# Autodesk Inventor assembly: Z-Axis
(part 2 of 2)
- Mate:131: Suction Cup Fixation:1 ↔ ISO 4762 M4 x 16:7
- Mate:132: Suction Cup Fixation:1 ↔ ISO 4762 M4 x 16:7
- Mate:133: Suction Cup Fixation:1 ↔ ISO 4762 M4 x 16:6
- Mate:134: SK12 SHAFT HOLDER:1 ↔ ISO 4762 M5 x 20:14
- Mate:135: SK12 SHAFT HOLDER:1 ↔ ISO 4762 M5 x 20:14
- Mate:136: SK12 SHAFT HOLDER:1 ↔ ISO 4762 M5 x 20:13
- Mate:137: SK12 SHAFT HOLDER:1 ↔ ISO 4762 M5 x 20:13
- Mate:144: Suction:1 ↔ Product Base:1
- Mate:145: Suction:1 ↔ Product Base:1
- Mate:146: SK12 SHAFT HOLDER:1 ↔ IPCF06-02:1
- Mate:147: Suction:1 ↔ IPCF06-02:1
- Mate:148: Linear Bearing Spacer:1 ↔ ISO 4762 M4 x 12:4
- Mate:149: Linear Bearing Spacer:1 ↔ ISO 4762 M4 x 12:3
- Mate:150: Suction Cup Fixation:1 ↔ ISO 4762 M4 x 12:6
- Mate:151: Suction Cup Fixation:1 ↔ ISO 4762 M4 x 12:5
- Mate:152: Suction Cup Fixation:1 ↔ ISO 4762 M4 x 12:7
- Mate:153: Suction Cup Fixation:1 ↔ ISO 4762 M4 x 12:8
- Mate:154: Suction Cup Fixation:1 ↔ ISO 4762 M4 x 12:6
- Mate:155: Suction Cup Fixation:1 ↔ ISO 4762 M4 x 12:5
- Mate:156: Suction Cup Fixation:1 ↔ ISO 4762 M4 x 12:8
- Mate:157: Suction Cup Fixation:1 ↔ ISO 4762 M4 x 12:7
- Mate:158: ISO 4762 M5 x 20:14 ↔ ISO 4032 M5:13
- Mate:160: ISO 4762 M5 x 20:13 ↔ ISO 4032 M5:14
- Insert:33: Suction Cup Fixation:1 ↔ Plain Washer (Metric) 5 N:1
- Insert:34: Suction Cup Fixation:1 ↔ Plain Washer (Metric) 5 N:2
- Mate:161: ISO 4032 M5:13 ↔ Plain Washer (Metric) 5 N:1
- Mate:162: ISO 4032 M5:14 ↔ Plain Washer (Metric) 5 N:2
- Mate:163: ISO 4762 M5 x 20:11 ↔ Plain Washer (Metric) 5 N:3
- Mate:164: 127x88 Gantry:1 ↔ Plain Washer (Metric) 5 N:3
- Mate:165: ISO 4762 M5 x 20:10 ↔ Plain Washer (Metric) 5 N:6
- Mate:166: ISO 4762 M5 x 20:6 ↔ Plain Washer (Metric) 5 N:4
- Mate:167: ISO 4762 M5 x 20:5 ↔ Plain Washer (Metric) 5 N:5
- Mate:168: 127x88 Gantry:1 ↔ Plain Washer (Metric) 5 N:5
- Mate:169: 127x88 Gantry:1 ↔ Plain Washer (Metric) 5 N:4
- Mate:170: 127x88 Gantry:1 ↔ Plain Washer (Metric) 5 N:6
- Mate:171: ISO 4762 M5 x 20:12 ↔ Plain Washer (Metric) 5 N:9
- Mate:172: ISO 4762 M5 x 20:7 ↔ Plain Washer (Metric) 5 N:8
- Mate:173: ISO 4762 M5 x 20:8 ↔ Plain Washer (Metric) 5 N:10
- Mate:174: ISO 4762 M5 x 20:9 ↔ Plain Washer (Metric) 5 N:7
- Mate:175: 127x88 Gantry:1 ↔ Plain Washer (Metric) 5 N:7
- Mate:176: 127x88 Gantry:1 ↔ Plain Washer (Metric) 5 N:10
- Mate:177: 127x88 Gantry:1 ↔ Plain Washer (Metric) 5 N:8
- Mate:178: 127x88 Gantry:1 ↔ Plain Washer (Metric) 5 N:9
- Mate:179: Linear Bearing Spacer:2 ↔ ISO 4762 M4 x 12:5
- Insert:35: Z Bracket:1 ↔ ISO 4032 M2:1
- Insert:36: Z Bracket:1 ↔ ISO 4032 M2:2
- Mate:197: NO-NC Bump Switch:3 ↔ ISO 4762 M2 x 16:2
- Mate:198: NO-NC Bump Switch:3 ↔ ISO 4762 M2 x 16:1
- Mate:200: ISO 4762 M2 x 16:2 ↔ Plain Washer (Metric) 2 N:2
- Mate:201: NO-NC Bump Switch:3 ↔ Plain Washer (Metric) 2 N:2
- Mate:202: ISO 4762 M2 x 16:1 ↔ Plain Washer (Metric) 2 N:3
- Mate:203: NO-NC Bump Switch:3 ↔ Plain Washer (Metric) 2 N:3
- Mate:204: ISO 4762 M2 x 16:1 ↔ Plain Washer (Metric) 2 N:3
- Mate:205: ISO 4762 M2 x 16:2 ↔ Plain Washer (Metric) 2 N:2
- Mate:206: Z Bracket:1 ↔ Limit Switch Spacer:1
- Mate:207: Limit Switch Spacer:1 ↔ ISO 4762 M2 x 16:1
- Mate:208: Limit Switch Spacer:1 ↔ ISO 4762 M2 x 16:2
- Mate:209: Z Bracket:1 ↔ ISO 4762 M2 x 16:1
- Mate:210: Z Bracket:1 ↔ ISO 4762 M2 x 16:2
- Mate:211: Limit Switch Spacer:1 ↔ NO-NC Bump Switch:3
- Mate:213: Limit Switch Spacer:2 ↔ NO-NC Bump Switch:2
- Mate:214: Limit Switch Spacer:2 ↔ NO-NC Bump Switch:2
- Mate:216: Limit Switch Spacer:2 ↔ NO-NC Bump Switch:2
- Angle:8 (180 deg): Z Bracket:1 ↔ Limit Switch Spacer:2
- Mate:217: Z Bracket:1 ↔ Limit Switch Spacer:2
- Mate:219 (33 mm): NO-NC Bump Switch:2 ↔ Bearing Spacer:1
- Mate:224: 17HS4401:1 ↔ ISO 4762 M3 x 16:10
- Mate:225: 17HS4401:1 ↔ ISO 4762 M3 x 16:9
- Insert:37: Z Bracket:1 ↔ ISO 4032 M2:3
- Insert:38: Z Bracket:1 ↔ ISO 4032 M2:4
- [Mate]: Plain Washer (Metric) 2 N:4 ↔ ISO 4762 M2 x 16:3
- [Mate]: Plain Washer (Metric) 2 N:5 ↔ ISO 4762 M2 x 16:4
- [Mate]: Plain Washer (Metric) 2 N:5 ↔ ISO 4762 M2 x 16:4
- [Mate]: Plain Washer (Metric) 2 N:4 ↔ ISO 4762 M2 x 16:3
- Mate:231: NO-NC Bump Switch:2 ↔ ISO 4762 M2 x 16:3
- Mate:232: NO-NC Bump Switch:2 ↔ ISO 4762 M2 x 16:4
- Mate:233: Plain Washer (Metric) 2 N:5 ↔ NO-NC Bump Switch:2
- Mate:234: Plain Washer (Metric) 2 N:4 ↔ NO-NC Bump Switch:2
- Mate:235: Z Bracket:1 ↔ Insert M3 D5 L5mm:1
- Flush:17: Z Bracket:1 ↔ Insert M3 D5 L5mm:1
- Mate:236: Z Bracket:1 ↔ Insert M3 D5 L5mm:2
- Flush:18: Z Bracket:1 ↔ Insert M3 D5 L5mm:2
- Mate:237: Insert M3 D5 L5mm:2 ↔ ISO 4762 M3 x 12:4
- Mate:238: Insert M3 D5 L5mm:1 ↔ ISO 4762 M3 x 12:3
- Mate:239: ISO 4762 M3 x 12:4 ↔ Plain Washer (Metric) 3 N:1
- Mate:240: ISO 4762 M3 x 12:4 ↔ Plain Washer (Metric) 3 N:1
- Mate:242: ISO 4762 M3 x 12:3 ↔ Plain Washer (Metric) 3 N:2
- Mate:244: ISO 4762 M3 x 12:3 ↔ Plain Washer (Metric) 3 N:2
- Mate:245 (-42.5 mm): 2020aluminum_extrusion_black:1 ↔ Gantry_Plate_65x65:2
- Mate:246: 2020aluminum_extrusion_black:1 ↔ Gantry_Plate_65x65:2
- Mate:247 (-32.75 mm): 2020aluminum_extrusion_black:1 ↔ Gantry_Plate_65x65:2
- Mate:252: 2020aluminum_extrusion_black:1 ↔ Drag Chain Support:1
- Insert:39: SK8 Linear Shaft Support, 8mm v4:1 ↔ Plain Washer (Metric) 5 N:11
- Insert:40: SK8 Linear Shaft Support, 8mm v4:1 ↔ Plain Washer (Metric) 5 N:12
- Insert:41: SK8 Linear Shaft Support, 8mm v4:2 ↔ Plain Washer (Metric) 5 N:13
- Insert:42: SK8 Linear Shaft Support, 8mm v4:2 ↔ Plain Washer (Metric) 5 N:14
- Insert:43: SHF8:1 ↔ Plain Washer (Metric) 5 N:15
- Insert:44: SHF8:1 ↔ Plain Washer (Metric) 5 N:16
- Insert:45: SHF8_MIR:1 ↔ Plain Washer (Metric) 5 N:18
- Insert:46: SHF8_MIR:1 ↔ Plain Washer (Metric) 5 N:17
- Flush:21 (-2 mm): GT2 Belt 6mm x 40mm:1 ↔ 127x88 Gantry:1
- Flush:22 (7 mm): 2020aluminum_extrusion_black:1 ↔ GT2 Belt 6mm x 40mm:1
- Flush:23 (7 mm): 2020aluminum_extrusion_black:1 ↔ GT2 Belt 6mm x 40mm:2
- Flush:24 (-2 mm): GT2 Belt 6mm x 40mm:2 ↔ 127x88 Gantry:1
- Flush:25: Z Bracket:1 ↔ NO-NC Bump Switch:2
- Insert:47: SK12 SHAFT HOLDER:1 ↔ ISO 4762 M4 x 16:8
- [Mate]: ISO 4762 M2 x 16:5 ↔ ISO 4032 M2:5
- [Mate]: ISO 4762 M2 x 16:5 ↔ Plain Washer (Metric) 2 N:6
- Mate:291: Gantry_Plate_65x65:2 ↔ ISO 4762 M2 x 16:5
- Mate:293: ISO 4762 M2 x 16:5 ↔ Plain Washer (Metric) 2 N:6
- Angle:11 (0 deg): 2020aluminum_extrusion_black:1 ↔ motor holder bracket:1
- Flush:26 (-3.5 mm): 2020aluminum_extrusion_black:1 ↔ motor holder bracket:1
- Mate:305: motor holder bracket:1 ↔ Slider T-Nut for 2020 - M3:1
- Mate:306: motor holder bracket:1 ↔ Slider T-Nut for 2020 - M3:2
- Flush:308: 2020aluminum_extrusion_black:1 ↔ Slider T-Nut for 2020 - M3:1
- Mate:307: 2020aluminum_extrusion_black:1 ↔ Slider T-Nut for 2020 - M3:1
- Angle:12 (0 deg): Slider T-Nut for 2020 - M3:1 ↔ Slider T-Nut for 2020 - M3:2
- Mate:308: 2020aluminum_extrusion_black:1 ↔ Slider T-Nut for 2020 - M3:2
- Mate:309: motor holder bracket:1 ↔ ISO 4762 M3 x 12:5
- Mate:310: ISO 4762 M3 x 12:5 ↔ Plain Washer (Metric) 3 N:7
- Mate:311: motor holder bracket:1 ↔ Plain Washer (Metric) 3 N:7
- Mate:312: ISO 4762 M3 x 12:5 ↔ Plain Washer (Metric) 3 N:7
- Mate:313: motor holder bracket:1 ↔ ISO 4762 M3 x 12:6
- Mate:314: ISO 4762 M3 x 12:6 ↔ Plain Washer (Metric) 3 N:8
- Mate:315: motor holder bracket:1 ↔ Plain Washer (Metric) 3 N:8
- Mate:316: ISO 4762 M3 x 12:6 ↔ Plain Washer (Metric) 3 N:8
- Mate:317: motor holder bracket:1 ↔ Motor:1
- Mate:319: motor holder bracket:1 ↔ Motor:1
- Mate:320: motor holder bracket:1 ↔ Motor:1
- Mate:321: Motor:1 ↔ GT2 Pulley Assembly With Grub Screws:1
- Mate:322 (1 mm): 2020aluminum_extrusion_black:1 ↔ GT2 Pulley Assembly With Grub Screws:1
- Mate:332: ISO 7045 Z M2 x 10 - 4.8 - Z:4 ↔ Plain Washer (Metric) 2 N:13
- Mate:333: ISO 7045 Z M2 x 10 - 4.8 - Z:1 ↔ Plain Washer (Metric) 2 N:14
- Mate:334: ISO 7045 Z M2 x 10 - 4.8 - Z:4 ↔ Plain Washer (Metric) 2 N:13
- Mate:335: ISO 7045 Z M2 x 10 - 4.8 - Z:1 ↔ Plain Washer (Metric) 2 N:14
- Mate:336: motor holder bracket:1 ↔ DC Motor Bracket Spacer:1
- Mate:337: motor holder bracket:1 ↔ DC Motor Bracket Spacer:1
- Mate:339: DC Motor Bracket Spacer:1 ↔ DC Motor Bracket Spacer:2
- Mate:340: DC Motor Bracket Spacer:1 ↔ DC Motor Bracket Spacer:2
- Mate:341: motor holder bracket:1 ↔ DC Motor Bracket Spacer:1
- Mate:342: DC Motor Bracket Spacer:1 ↔ DC Motor Bracket Spacer:2
- Mate:343: 2020aluminum_extrusion_black:1 ↔ DC Motor Bracket Spacer:2
- Mate:344: motor holder bracket:1 ↔ ISO 7045 Z M2 x 10 - 4.8 - Z:1
- Mate:345: motor holder bracket:1 ↔ ISO 7045 Z M2 x 10 - 4.8 - Z:4
- Mate:346: motor holder bracket:1 ↔ Plain Washer (Metric) 2 N:13
- Mate:347: motor holder bracket:1 ↔ Plain Washer (Metric) 2 N:14
- Insert:48: Gantry_Plate_65x65:2 ↔ V-Pulley:5
- Insert:49: Gantry_Plate_65x65:2 ↔ V-Pulley:8
- Insert:50: Gantry_Plate_65x65:2 ↔ V-Pulley:7
- Insert:51: Gantry_Plate_65x65:2 ↔ V-Pulley:6
- Mate:348: Gantry_Plate_65x65:2 ↔ ISO 4032 M2:5
- Mate:351: Gantry_Plate_65x65:2 ↔ Slider T-Nut for 2020 - M5:1
- Angle:14 (0 deg): 2020aluminum_extrusion_black:1 ↔ Slider T-Nut for 2020 - M5:1
- Mate:353: 2020aluminum_extrusion_black:1 ↔ Slider T-Nut for 2020 - M5:1
- Mate:354: Gantry_Plate_65x65:2 ↔ ISO 4762 M5 x 10:5
- Mate:355: ISO 4762 M5 x 10:5 ↔ Plain Washer (Metric) 5 N:19
- Mate:356: Gantry_Plate_65x65:2 ↔ Plain Washer (Metric) 5 N:19
- Mate:357: ISO 4762 M5 x 10:5 ↔ Plain Washer (Metric) 5 N:19
- Mate:358: Drag Chain Support:1 ↔ V-Pulley:6
- Mate:359: Gantry_Plate_65x65:2 ↔ Drag Chain Support:1
- [Mate]: ISO 4762 M5 x 10:6 ↔ Plain Washer (Metric) 5 N:20
- [Mate]: ISO 4762 M5 x 10:6 ↔ Plain Washer (Metric) 5 N:20
- Mate:367: Gantry_Plate_65x65:2 ↔ ISO 4762 M5 x 10:6
- Mate:368: Slider T-Nut for 2020 - M5:2 ↔ ISO 4762 M5 x 10:6
- Mate:369: 2020aluminum_extrusion_black:1 ↔ Slider T-Nut for 2020 - M5:2
- Mate:370: Gantry_Plate_65x65:2 ↔ Plain Washer (Metric) 5 N:20
- Mate:372 (3.395 mm): 2020aluminum_extrusion_black:1 ↔ LimitSwitchMountPlate:1
- Mate:373: 2020aluminum_extrusion_black:1 ↔ LimitSwitchMountPlate:1
- Mate:374 (3.395 mm): 2020aluminum_extrusion_black:1 ↔ LimitSwitchMountPlate:1
- Mate:375: LimitSwitchMountPlate:1 ↔ NO-NC Bump Switch:5
- Mate:376: LimitSwitchMountPlate:1 ↔ NO-NC Bump Switch:5
- Mate:377: LimitSwitchMountPlate:1 ↔ NO-NC Bump Switch:5
- Mate:378 (20 mm): motor holder bracket:1 ↔ LimitSwitchMountPlate:1
- [Mate]: ISO 4762 M3 x 16:12 ↔ ISO 4032 M3:12
- [Mate]: ISO 4762 M3 x 16:12 ↔ Plain Washer (Metric) 3 N:9
- [Mate]: ISO 4762 M3 x 16:12 ↔ Plain Washer (Metric) 3 N:9
- [Insert]: Gantry_Plate_65x65:3 ↔ V-Pulley:9
- [Insert]: Gantry_Plate_65x65:3 ↔ V-Pulley:12
- [Insert]: Gantry_Plate_65x65:3 ↔ V-Pulley:11
- [Insert]: Gantry_Plate_65x65:3 ↔ V-Pulley:10
- [Mate]: Gantry_Plate_65x65:3 ↔ Slider T-Nut for 2020 - M5:3
- [Mate]: Gantry_Plate_65x65:3 ↔ ISO 4762 M5 x 10:7
- [Mate]: ISO 4762 M5 x 10:7 ↔ Plain Washer (Metric) 5 N:21
- [Mate]: Gantry_Plate_65x65:3 ↔ Plain Washer (Metric) 5 N:21
- [Mate]: ISO 4762 M5 x 10:7 ↔ Plain Washer (Metric) 5 N:21
- [Mate]: ISO 4762 M5 x 10:8 ↔ Plain Washer (Metric) 5 N:22
- [Mate]: ISO 4762 M5 x 10:8 ↔ Plain Washer (Metric) 5 N:22
- [Mate]: Gantry_Plate_65x65:3 ↔ ISO 4762 M5 x 10:8
- [Mate]: Slider T-Nut for 2020 - M5:4 ↔ ISO 4762 M5 x 10:8
- [Mate]: Gantry_Plate_65x65:3 ↔ Plain Washer (Metric) 5 N:22
- Mate:393: 2020aluminum_extrusion_black:1 ↔ Slider T-Nut for 2020 - M5:4
- Mate:394: 2020aluminum_extrusion_black:1 ↔ Slider T-Nut for 2020 - M5:3
- Mate:395 (3.395 mm): 2020aluminum_extrusion_black:1 ↔ Slider T-Nut for 2020 - M5:4
- Mate:396 (3.395 mm): 2020aluminum_extrusion_black:1 ↔ Slider T-Nut for 2020 - M5:3
- Mate:397 (417 mm): Gantry_Plate_65x65:2 ↔ Gantry_Plate_65x65:3
- Angle:16 (0 deg): 2020aluminum_extrusion_black:1 ↔ Slider T-Nut for 2020 - M5:4
- Angle:17 (0 deg): 2020aluminum_extrusion_black:1 ↔ Slider T-Nut for 2020 - M5:3
- Mate:398: 2020aluminum_extrusion_black:1 ↔ Gantry_Plate_65x65:3
- Mate:399: 2020aluminum_extrusion_black:1 ↔ 2020 Belt Tensioner G_K:1
- Mate:400 (2 mm): 2020aluminum_extrusion_black:1 ↔ 2020 Belt Tensioner G_K:1
- Flush:309: 2020aluminum_extrusion_black:1 ↔ Gantry_Plate_65x65:2
- Flush:310: 2020aluminum_extrusion_black:1 ↔ 2020 Belt Tensioner G_K:1
- Mate:401: 2020 Belt Tensioner G_K:1 ↔ M4 T slot nut - 2020:1
- Mate:402: 2020 Belt Tensioner G_K:1 ↔ M4 T slot nut - 2020:2
- Angle:18 (90 deg): 2020aluminum_extrusion_black:1 ↔ M4 T slot nut - 2020:1
- Angle:19 (90 deg): 2020 Belt Tensioner G_K:1 ↔ M4 T slot nut - 2020:2
- Mate:403: 2020aluminum_extrusion_black:1 ↔ M4 T slot nut - 2020:2
- Mate:404: 2020aluminum_extrusion_black:1 ↔ M4 T slot nut - 2020:1
- Mate:405: Drag Chain Support:1 ↔ ISO 4762 M3 x 16:12
- Mate:406: Drag Chain Support:1 ↔ Plain Washer (Metric) 3 N:9
- Mate:407: 2020 Belt Tensioner G_K:1 ↔ ISO 4762 M4 x 12:9
- Mate:408: 2020 Belt Tensioner G_K:1 ↔ ISO 4762 M4 x 12:10
- Mate:409: ISO 4762 M3 x 16:12 ↔ Plain Washer (Metric) 3 N:10
- Mate:410: Gantry_Plate_65x65:3 ↔ Plain Washer (Metric) 3 N:10
- Mate:411: ISO 4032 M3:12 ↔ Plain Washer (Metric) 3 N:10
- Mate:412: ISO 4762 M4 x 12:9 ↔ Plain Washer (Metric) 4 N:1
- Mate:413: ISO 4762 M4 x 12:10 ↔ Plain Washer (Metric) 4 N:2
- Mate:414: 2020 Belt Tensioner G_K:1 ↔ Plain Washer (Metric) 4 N:1
- Mate:415: 2020 Belt Tensioner G_K:1 ↔ Plain Washer (Metric) 4 N:2
- Mate:416: ISO 4762 M4 x 12:10 ↔ Plain Washer (Metric) 4 N:2
- Mate:417: ISO 4762 M4 x 12:9 ↔ Plain Washer (Metric) 4 N:1
- [Angle] (0 deg): Slider T-Nut for 2020 - M3:3 ↔ Slider T-Nut for 2020 - M3:4
- [Mate]: ISO 4762 M3 x 10:2 ↔ Plain Washer (Metric) 3 N:11
- [Mate]: ISO 4762 M3 x 10:2 ↔ Plain Washer (Metric) 3 N:11
- [Mate]: ISO 4762 M3 x 10:1 ↔ Plain Washer (Metric) 3 N:12
- [Mate]: ISO 4762 M3 x 10:1 ↔ Plain Washer (Metric) 3 N:12
- Mate:422: LimitSwitchMountPlate:1 ↔ Slider T-Nut for 2020 - M3:4
- Mate:423: 2020aluminum_extrusion_black:1 ↔ Slider T-Nut for 2020 - M3:4
- Mate:424: 2020aluminum_extrusion_black:1 ↔ Slider T-Nut for 2020 - M3:3
- Angle:21 (0 deg): 2020aluminum_extrusion_black:1 ↔ Slider T-Nut for 2020 - M3:4
- Angle:22 (0 deg): 2020aluminum_extrusion_black:1 ↔ Slider T-Nut for 2020 - M3:3
- Mate:425: Slider T-Nut for 2020 - M3:4 ↔ ISO 4762 M3 x 10:2
- Mate:426: Slider T-Nut for 2020 - M3:3 ↔ ISO 4762 M3 x 10:1
- Mate:427: LimitSwitchMountPlate:1 ↔ Plain Washer (Metric) 3 N:11
- Mate:428: LimitSwitchMountPlate:1 ↔ Slider T-Nut for 2020 - M3:3
- Mate:429: LimitSwitchMountPlate:1 ↔ Plain Washer (Metric) 3 N:12
- [Mate]: ISO 4762 M2 x 16:7 ↔ ISO 4032 M2:8
- [Mate]: ISO 4762 M2 x 16:7 ↔ Plain Washer (Metric) 2 N:15
- [Mate]: ISO 4762 M2 x 16:7 ↔ Plain Washer (Metric) 2 N:15
- [Mate]: ISO 4762 M2 x 16:8 ↔ ISO 4032 M2:9
- [Mate]: ISO 4762 M2 x 16:8 ↔ Plain Washer (Metric) 2 N:16
- [Mate]: ISO 4762 M2 x 16:8 ↔ Plain Washer (Metric) 2 N:16
- Mate:436: NO-NC Bump Switch:5 ↔ ISO 4762 M2 x 16:7
- Mate:437: NO-NC Bump Switch:5 ↔ ISO 4762 M2 x 16:8
- Mate:438: NO-NC Bump Switch:5 ↔ Plain Washer (Metric) 2 N:15
- Mate:439: NO-NC Bump Switch:5 ↔ Plain Washer (Metric) 2 N:16
- Mate:440: LimitSwitchMountPlate:1 ↔ ISO 4032 M2:9
- Mate:441: LimitSwitchMountPlate:1 ↔ ISO 4032 M2:8
- Mate:442 (2 mm): ISO 4762 M3 x 12:4 ↔ Drag Chain Start Link:3
- Mate:443: Z Bracket:1 ↔ Drag Chain Start Link:3
- Mate:444: Plain Washer (Metric) 3 N:2 ↔ Drag Chain Start Link:3
- Mate:445: Plain Washer (Metric) 3 N:1 ↔ Drag Chain Start Link:3
- Mate:447: Path:1 ↔ Drag Chain Middle Link:1
- Angle:23 (0 deg): Drag Chain Support:1 ↔ Drag Chain Middle Link:1
- Mate:450: ISO 4026 M3 x 16:1 ↔ ISO 4032 M3:3
- Mate:453: Gantry_Plate_65x65:2 ↔ ISO 7045 Z M3 x 16 - 4.8 - Z:1
- Mate:455: Gantry_Plate_65x65:2 ↔ ISO 7380-1 M3 x 16:1
- Mate:457: ISO 7380-1 M3 x 16:1 ↔ Plain Washer (Metric) 3 N:13
- Mate:459: ISO 4032 M3:3 ↔ Plain Washer (Metric) 3 N:13
- [Mate]: ISO 4762 M3 x 12:7 ↔ ISO 4032 M3:13
- [Mate]: ISO 4762 M3 x 12:7 ↔ Plain Washer (Metric) 3 N:15
- [Mate]: ISO 4032 M3:13 ↔ Plain Washer (Metric) 3 N:15
- [Mate]: ISO 4762 M3 x 12:8 ↔ Plain Washer (Metric) 3 N:16
- [Mate]: ISO 4762 M3 x 12:8 ↔ Plain Washer (Metric) 3 N:16
- Mate:470: Drag Chain Support:1 ↔ ISO 4762 M3 x 12:7
- Mate:472: Gantry_Plate_65x65:2 ↔ Plain Washer (Metric) 3 N:15
- Mate:473: Drag Chain Support:1 ↔ ISO 4762 M3 x 12:7
- Mate:474 (2 mm): Drag Chain Support:1 ↔ Drag Chain Start Link:2
- Mate:475: Drag Chain Support:1 ↔ Drag Chain Start Link:2
- Mate:476 (2 mm): Drag Chain Support:1 ↔ Drag Chain Start Link:2
- Mate:477 (2 mm): 2020aluminum_extrusion_black:1 ↔ Drag Chain Start Link:2
- Mate:478 (2 mm): ISO 4762 M3 x 12:3 ↔ Drag Chain Start Link:3
- Mate:479 (2 mm): ISO 4762 M3 x 12:4 ↔ Drag Chain Start Link:3
- Flush:311: Drag Chain Start Link:2 ↔ Drag Chain Start Link:3
- Mate:483: Drag Chain Support:1 ↔ ISO 4762 M3 x 12:8
- Mate:484: Drag Chain Start Link:2 ↔ Plain Washer (Metric) 3 N:16
- Mate:486: ISO 4762 M3 x 12:8 ↔ ISO 4032 M3:14
- Mate:487: Drag Chain Support:1 ↔ ISO 4032 M3:14
- [Mate]: ISO 4762 M3 x 12:10 ↔ Plain Washer (Metric) 3 N:18
- [Mate]: ISO 4762 M3 x 12:10 ↔ Plain Washer (Metric) 3 N:18
- [Mate]: ISO 4762 M3 x 12:10 ↔ ISO 4032 M3:15
- Mate:497: Drag Chain Support:1 ↔ ISO 4762 M3 x 12:10
- Mate:498: Drag Chain Start Link:2 ↔ Plain Washer (Metric) 3 N:18
- Mate:499: ISO 4762 M3 x 12:10 ↔ ISO 4032 M3:15
- Mate:500: Drag Chain Support:1 ↔ ISO 4032 M3:15
- Flush:313: Drag Chain Start Link:3 ↔ 90 Degree Drag Chain Link:1
- Mate:507: Drag Chain Support:1 ↔ 90 Degree Drag Chain Link:1
- Mate:508 (2 mm): ISO 4762 M3 x 12:8 ↔ 90 Degree Drag Chain Link:1
- [Mate]: ISO 4762 M3 x 12:12 ↔ Plain Washer (Metric) 3 N:20
- [Mate]: ISO 4762 M3 x 12:12 ↔ Plain Washer (Metric) 3 N:20
- [Mate]: ISO 4762 M3 x 12:12 ↔ ISO 4032 M3:16
- [Mate]: ISO 4762 M3 x 12:13 ↔ Plain Washer (Metric) 3 N:21
- [Mate]: ISO 4762 M3 x 12:13 ↔ Plain Washer (Metric) 3 N:21
- [Mate]: ISO 4762 M3 x 12:13 ↔ ISO 4032 M3:17
- Mate:515 (2 mm): 90 Degree Drag Chain Link:1 ↔ ISO 4762 M3 x 12:13
- Mate:516: Drag Chain Support:1 ↔ ISO 4762 M3 x 12:13
- Mate:517: Drag Chain Support:1 ↔ ISO 4762 M3 x 12:12
- Mate:518: Drag Chain Support:1 ↔ ISO 4032 M3:17
- Mate:519: Drag Chain Support:1 ↔ ISO 4032 M3:16
- Mate:520: 90 Degree Drag Chain Link:1 ↔ Plain Washer (Metric) 3 N:21
- Mate:521: 90 Degree Drag Chain Link:1 ↔ Plain Washer (Metric) 3 N:20
- [Mate]: ISO 4762 M3 x 16:13 ↔ ISO 4032 M3:18
- [Mate]: ISO 4762 M3 x 16:13 ↔ Plain Washer (Metric) 3 N:22
- [Mate]: ISO 4762 M3 x 16:13 ↔ Plain Washer (Metric) 3 N:22
- [Mate]: ISO 4762 M3 x 16:13 ↔ Plain Washer (Metric) 3 N:23
- [Mate]: ISO 4032 M3:18 ↔ Plain Washer (Metric) 3 N:23
- Mate:527: Drag Chain Support:1 ↔ ISO 4762 M3 x 16:13
- Mate:528: Drag Chain Support:1 ↔ Plain Washer (Metric) 3 N:22
- Mate:529: Gantry_Plate_65x65:2 ↔ Plain Washer (Metric) 3 N:23
- Mate:530 (20.023 mm): Z Bracket:1 ↔ LimitSwitchMountPlate:1
- Symmetry:1: Gantry_Plate_65x65:2 ↔ Gantry_Plate_65x65:3
- Mate:531: SCS8UU Block, Linear Bearing, 8mm:1 ↔ Linear Bearing Spacer:1
- Mate:532: T8 nut:1 ↔ t8_nut_housing:1
- Mate:533: T8 nut:1 ↔ t8_nut_housing:1
- Insert:56: T8 nut:1 ↔ ISO 4762 M3 x 12:14
- Insert:57: T8 nut:1 ↔ ISO 4762 M3 x 12:15
- Mate:534: Trapezoidal lead screw tr8x8-4:1 ↔ T8 nut:1
- Mate:535: Linear Bearing Spacer:1 ↔ Suction Cup Fixation:1
- Mate:536: Suction Cup Fixation:1 ↔ t8_nut_housing:1
- Mate:537: ISO 4762 M4 x 8:3 ↔ t8_nut_housing:1
## Named parameters: M3_Insert_Nut_Hole = 4 mm, M4_Insert_Nut_Hole = 1 mm, M5_Insert_Nut_Hole = 5.7 mm, d398_d362 = 0 mm, d399_d363 = 0 mm, d400_d364 = 0 mm, d401_d366 = 0 mm, d402_d367 = 0 mm, d403_d368 = 0 mm, d404_d370 = 0 mm, d405_d371 = 0 mm, d558_d544_d315 = 0 mm, d559_d545_d168 = 0 mm, d659_d640 = 0 mm, d660_d642 = 0 mm, d673_d659_d640 = 0 mm, d674_d660_d642 = 0 mm, d675_d661 = 0 mm, d676_d662 = 0 mm, d677_d664 = 0 mm, d678_d623 = 0 mm, d679_d624 = 0 mm, d680_d625 = 0 mm, d681_d626 = 0 mm, d683_d634 = 0 mm, d684_d639 = 0 mm, d685_d640 = 0 mm, d686_d641 = 0 mm, d687_d642 = 0 mm, d688_d544_d315 = 0 mm, d689_d545_d168 = 0 mm, d690_d566 = 0 mm, d723_d582 = 0 deg, d724_d585 = 0 mm, d725_d587 = 0 mm, d726_d589 = 0 mm, d727_d591 = 0 mm, d738_d558_d544_d315 = 0 mm, d739_d559_d545_d168 = 0 mm, d740_d563 = 0 mm, d741_d558_d544_d315 = 0 mm, d742_d559_d545_d168 = 0 mm, d743_d563 = 0 mm, d835_d713 = 0 mm, d836_d716 = 0 mm, d838_d689_d545_d168 = 0 mm, d842_d688_d544_d315 = 0 mm, d844_d690_d566 = 0 mm, d869_d863 = 0 mm, d870_d842_d688_d544_d315 = 0 mm, d871_d844_d690_d566 = 0 mm, d888_d866_d863 = 0 mm, d889_d867_d842_d688_d544_d315 = 0 mm, d890_d868_d844_d690_d566 = 0 mm, d891_d872_d863 = 0 mm, d892_d873_d842_d688_d544_d315 = 0 mm, d893_d874_d844_d690_d566 = 0 mm, d901_d713 = 0 mm, d902_d716 = 0 mm, d903_d688_d544_d315 = 0 mm, d904_d689_d545_d168 = 0 mm, d905_d690_d566 = 0 mm
